# Autodesk Inventor assembly: Laser Rx Fixation
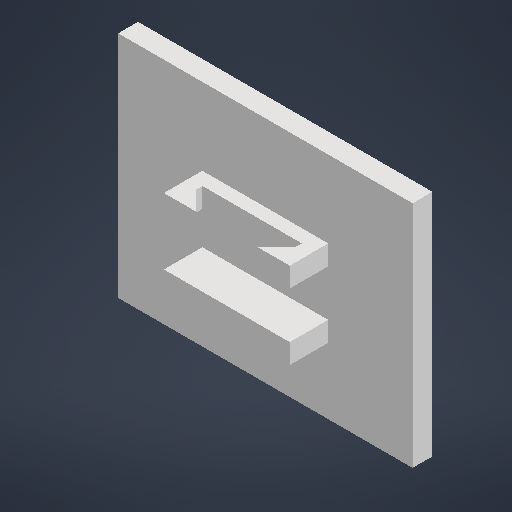
[picture p0: Inventor's stored thumbnail of the model, 512x512]
Saved by Autodesk Inventor 2027.1 (Build 311270010, 270A)
## iProperties
Created: 2026-10-18
Part Number: Laser Rx Fixation
Document SubType Name: Assembly
Designer: Ahmed
Author: Ahmed
## Documents named in this file (4)
- C:\Users\Ahmed\Desktop\Fall 26\MCT333 Design of Mechatronics Systems 1\Project\CAD\Laser Rx Fixation.iam
- C:\Users\Ahmed\Desktop\Fall 26\MCT333 Design of Mechatronics Systems 1\Project\CAD\Laser Rx Wall.ipt
- C:\Users\Ahmed\Desktop\Fall 26\MCT333 Design of Mechatronics Systems 1\Project\CAD\Laser Rx Base.ipt
- C:\Users\Ahmed\Desktop\Fall 26\MCT333 Design of Mechatronics Systems 1\Project\CAD\Laser Rx Slot.ipt
## Components (3 placed, 3 different names)
1. Laser Rx Wall:1 — Flush:1, Mate:1, Mate:2, Flush:2, Mate:3, Mate:4
2. Laser Rx Base:1 — Flush:1, Mate:1, Mate:2
3. Laser Rx Slot:1 — Flush:2, Mate:3, Mate:4
## Relationships (6: Mate 4, Flush 2)
- Flush:1: Laser Rx Wall:1 ↔ Laser Rx Base:1
- Mate:1: Laser Rx Wall:1 ↔ Laser Rx Base:1
- Mate:2: Laser Rx Wall:1 ↔ Laser Rx Base:1
- Flush:2: Laser Rx Wall:1 ↔ Laser Rx Slot:1
- Mate:3: Laser Rx Wall:1 ↔ Laser Rx Slot:1
- Mate:4: Laser Rx Wall:1 ↔ Laser Rx Slot:1
